# Autodesk Inventor assembly: MM0948AN100_G02_802
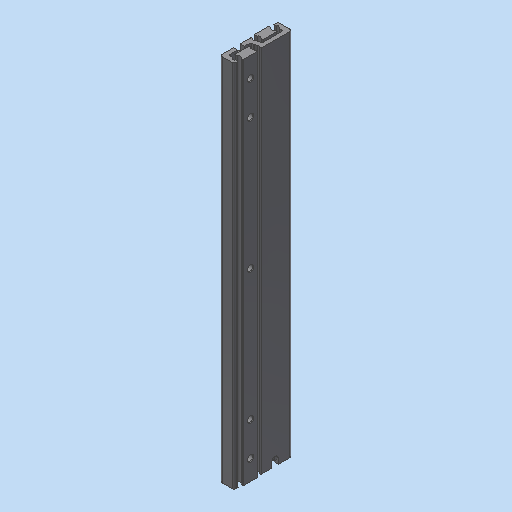
[picture p0: Inventor's stored thumbnail of the model, 512x512]
Saved by Autodesk Inventor 2023.3 (Build 273359000, 359)
## iProperties
RuleStatus: InUse
Company: rollon
Created: 2023-03-23
Part Number: MM0948AN100_G02_802
Catalog Web Link: www.cadenas.de
Description: =<RBPARTNOTITLE2>
Vendor: Rollon
Document SubType Name: Assembly
Designer: FH/Wi
Manufacturer: rollon
Mass: 88.3189 g
Surface Area: 577.263 cm^2
Volume: 88.3189 cm^3
Density: 1 g/cm^3
RBMATERIAL: =<Material>
RBMATNO: =<Part Number>
RBPARTMADEOF: LTF44-275
RBPARTNO: SIEHE MNR
RBPARTNOTITLE1: LTF-Telescopic rail
RBPARTNOTITLE2: LTF-Telescopic rail
RBGBDIM_01: 0,000 mm
RBGBDIM_02: 0,000 mm
RBGBDIM_03: 0,000 mm
RBGBDIM_04: 0,000 mm
RBGBVAULTPATH: C:\_Bibliothek\Vorlagen\Inventor\Templates
RBGBREMARKSINDEX: E
STATUS: in Work
AnP_Kategorie: 2
AnP_Material: =<Material>
RBDRAWINGMISSINGSPEC: --
Title: LTF44-275
Keywords: =<RBPARTMADEOF>
Comments: =<RBSURFACE2>
Author: FH/Wi
Revision Number: 01
## Documents named in this file (4)
- C:\Users\rea9an\Documents\Inventor\TCAI2412_te1910_EM\AS00000934.iam
- C:\Users\rea9an\Documents\Inventor\TCAI2412_te1910_EM\PT00004629.ipt
- C:\Users\rea9an\Documents\Inventor\TCAI2412_te1910_EM\PT00004628.ipt
- C:\_AnPCAD\_AnP_CAD\MM\MM0948AN_DispensenStandardbaugruppen\MM0948AN100_Waage\G02_Kaufteile\MM0948AN100_G02_802.iam
## Components (3 placed, 2 different names)
1. PT00004629:1 — Passend:3, Fluchtend:1, Hub1/2
2. PT00004628:1 — Passend:1, Passend:2, Passend:3, Fluchtend:1, Hub1/2, Hub2/2
3. PT00004629:2 — Passend:1, Passend:2, Hub2/2
## Relationships (6: Mate 3, Flush 3)
- Passend:1 [Mate] (-11.5 mm): PT00004628:1 ↔ PT00004629:2
- Passend:2 [Mate] (-11.25 mm): PT00004628:1 ↔ PT00004629:2
- Passend:3 [Mate] (-11.25 mm): PT00004629:1 ↔ PT00004628:1
- Fluchtend:1 [Flush] (11.5 mm): PT00004629:1 ↔ PT00004628:1
- Hub1/2 [Flush]: PT00004629:1 ↔ PT00004628:1
- Hub2/2 [Flush]: PT00004628:1 ↔ PT00004629:2
## Named parameters: RBGBDIM_01 = 0 mm, RBGBDIM_02 = 0 mm, RBGBDIM_03 = 0 mm, RBGBDIM_04 = 0 mm
